# Autodesk Inventor assembly: FEIBOT
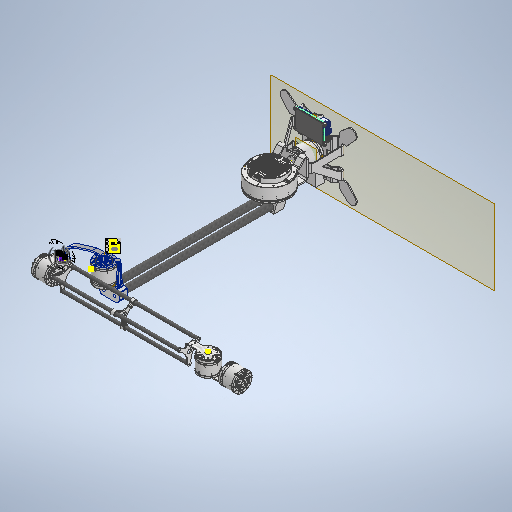
[picture p0: Inventor's stored thumbnail of the model, 512x512]
Saved by Autodesk Inventor 2025.3 (Build 293356000, 356)
## iProperties
Created: 2026-08-06
Part Number: FEIBOT
Document SubType Name: Assembly
Designer: Admin
Author: Admin
## Documents named in this file (21)
- C:\Users\shfzf\Desktop\FEIBOT\ROBOT_CAD\FEIBOT.iam
- C:\Users\shfzf\Desktop\FEIBOT\ROBOT_CAD\BASE\BASE.ipt
- C:\Users\shfzf\Desktop\FEIBOT\ROBOT_CAD\DM-J4340\DM-J4340.iam
- C:\Users\shfzf\Desktop\FEIBOT\ROBOT_CAD\DM-J10010l\DM-J10010l.iam
- C:\Users\shfzf\Desktop\FEIBOT\ROBOT_CAD\J1_J2_FLANGE\J1_J2_FLANGE.ipt
- C:\Users\shfzf\Desktop\FEIBOT\ROBOT_CAD\CARBON_TUBE\CARBON_TUBE_20MM.ipt
- C:\Users\shfzf\Desktop\FEIBOT\ROBOT_CAD\DC_DC_POWER.ipt
- C:\Users\shfzf\Desktop\FEIBOT\ROBOT_CAD\CARBON_TUBE\CARBON_TUBE.ipt
- C:\Users\shfzf\Desktop\FEIBOT\ROBOT_CAD\J4_CAR_CONNECTOR\J4_CAR_CONNECTOR.ipt
- C:\Users\shfzf\Desktop\FEIBOT\ROBOT_CAD\J1_J2_GASKET\J1_J2_GASKET.ipt
- C:\Users\shfzf\Desktop\FEIBOT\ROBOT_CAD\J2_HOLDER\J2_HOLDER.ipt
- C:\Users\shfzf\Desktop\FEIBOT\ROBOT_CAD\J2_CAR_CONNECTOR\J2_CAR_CONNECTOR.ipt
- C:\Users\shfzf\Desktop\FEIBOT\ROBOT_CAD\BOARD.iam
- C:\Users\shfzf\Desktop\FEIBOT\ROBOT_CAD\J3_J4_CONNECTOR.ipt
- C:\Users\shfzf\Desktop\FEIBOT\ROBOT_CAD\J3_J4_CONNECTOR_1.ipt
- C:\Users\shfzf\Desktop\FEIBOT\ROBOT_CAD\J5_J6_CONNECTOR.ipt
- C:\Users\shfzf\Desktop\FEIBOT\ROBOT_CAD\LINK_J3_CONNECTOR.ipt
- C:\Users\shfzf\Desktop\FEIBOT\ROBOT_CAD\DM-J4310\DM-J4310.iam
- C:\Users\shfzf\Desktop\FEIBOT\ROBOT_CAD\CAR_HOLDER.ipt
- C:\Users\shfzf\Desktop\FEIBOT\ROBOT_CAD\CAR_J4_CONNECTOR.ipt
- C:\Users\shfzf\Desktop\FEIBOT\ROBOT_CAD\CAR_TRI_FRAME.ipt
## Components (28 placed, 20 different names)
1. BASE:1 — 配合:1, 配合:2, 配合:3, 配合:4, 配合:5, 配合:6, 配合:22, 配合:23, 配合:24, 配合:36, 配合:37, 角度:1
2. DM-J4340:1 [sub-assembly] — 配合:49, 配合:50, 配合:51, 配合:52, 配合:53, 配合:54
3. DM-J4340:2 [sub-assembly] — 配合:4, 配合:5, 配合:6, 配合:7, 配合:8, 配合:35, 配合:44
4. DM-J10010l:1 [sub-assembly] — 配合:31, 配合:32, 配合:33, 配合:34, 配合:38, 配合:39, 配合:45
5. J1_J2_FLANGE:1 — 配合:7, 配合:8, 配合:25, 配合:26, 配合:30, 配合:44
6. DC_DC_POWER:1 — 配合:22, 配合:23, 配合:24
7. J4_CAR_CONNECTOR:1 — 配合:61, 配合:62, 配合:63, 配合:64, 配合:65, 配合:66, 配合:79, 配合:80, 配合:81, 配合:82, 配合:83
8. J1_J2_GASKET:1 — 配合:25, 配合:26, 配合:27, 配合:28, 配合:29, 配合:35
9. J2_HOLDER:1 — 配合:27, 配合:28, 配合:29, 配合:30, 配合:31, 配合:32, 配合:33, 配合:34
10. J2_CAR_CONNECTOR:1 — 配合:38, 配合:39, 配合:40, 配合:41, 配合:42, 配合:43, 配合:45
11. BOARD:1 [sub-assembly] — 配合:36, 配合:37, 角度:1
12. J3_J4_CONNECTOR:1 — 配合:52, 配合:53, 配合:54, 配合:55, 配合:56, 配合:57
13. J3_J4_CONNECTOR_1:1 — 配合:55, 配合:56, 配合:57, 配合:58, 配合:59, 配合:60
14. J5_J6_CONNECTOR:1 — 配合:67, 配合:68, 配合:69, 配合:70, 配合:71, 配合:72
15. LINK_J3_CONNECTOR:1 — 配合:46, 配合:47, 配合:48, 配合:49, 配合:50, 配合:51
16. DM-J4310:1 [sub-assembly] — 配合:67, 配合:68, 配合:69
17. DM-J4310:2 [sub-assembly] — 配合:70, 配合:71, 配合:72, 配合:73, 配合:74, 配合:75
18. DM-J4310:3 [sub-assembly] — 配合:58, 配合:59, 配合:60, 配合:79, 配合:80, 配合:81, 配合:82, 配合:83
19. CAR_HOLDER:1 — 配合:84, 配合:88, 配合:92
20. CAR_J4_CONNECTOR:1 — 配合:73, 配合:74, 配合:75, 配合:76, 配合:77, 配合:78
21. CAR_TRI_FRAME:1 — 配合:87, 配合:88, 配合:89, 配合:90, 配合:91, 配合:92
22. CAR_HOLDER:2 — 配合:86, 配合:89, 配合:90
23. CAR_HOLDER:3 — 配合:85, 配合:87, 配合:91
24. CARBON_TUBE_20MM:1 — 配合:41, 配合:43, 配合:47
25. CARBON_TUBE_20MM:2 — 配合:40, 配合:42, 配合:46, 配合:48
26. CARBON_TUBE:1 — 配合:61, 配合:65, 配合:76, 配合:78, 配合:86
27. CARBON_TUBE:2 — 配合:62, 配合:66, 配合:84
28. CARBON_TUBE:3 — 配合:63, 配合:64, 配合:77, 配合:85
## Relationships (80: Mate 79, Angle 1)
- 配合:1 [Mate]: BASE:1
- 配合:2 [Mate]: BASE:1
- 配合:3 [Mate]: BASE:1
- 配合:4 [Mate]: BASE:1 ↔ DM-J4340:2
- 配合:5 [Mate]: BASE:1 ↔ DM-J4340:2
- 配合:6 [Mate]: BASE:1 ↔ DM-J4340:2
- 配合:7 [Mate]: DM-J4340:2 ↔ J1_J2_FLANGE:1
- 配合:8 [Mate]: DM-J4340:2 ↔ J1_J2_FLANGE:1
- 配合:22 [Mate]: BASE:1 ↔ DC_DC_POWER:1
- 配合:23 [Mate]: BASE:1 ↔ DC_DC_POWER:1
- 配合:24 [Mate]: BASE:1 ↔ DC_DC_POWER:1
- 配合:25 [Mate]: J1_J2_FLANGE:1 ↔ J1_J2_GASKET:1
- 配合:26 [Mate]: J1_J2_FLANGE:1 ↔ J1_J2_GASKET:1
- 配合:27 [Mate]: J1_J2_GASKET:1 ↔ J2_HOLDER:1
- 配合:28 [Mate]: J1_J2_GASKET:1 ↔ J2_HOLDER:1
- 配合:29 [Mate]: J1_J2_GASKET:1 ↔ J2_HOLDER:1
- 配合:30 [Mate]: J1_J2_FLANGE:1 ↔ J2_HOLDER:1
- 配合:31 [Mate]: DM-J10010l:1 ↔ J2_HOLDER:1
- 配合:32 [Mate]: DM-J10010l:1 ↔ J2_HOLDER:1
- 配合:33 [Mate]: DM-J10010l:1 ↔ J2_HOLDER:1
- 配合:34 [Mate]: DM-J10010l:1 ↔ J2_HOLDER:1
- 配合:35 [Mate]: DM-J4340:2 ↔ J1_J2_GASKET:1
- 配合:36 [Mate]: BASE:1 ↔ BOARD:1
- 配合:37 [Mate]: BASE:1 ↔ BOARD:1
- 角度:1 [Angle] (0 deg): BASE:1 ↔ BOARD:1
- 配合:38 [Mate]: DM-J10010l:1 ↔ J2_CAR_CONNECTOR:1
- 配合:39 [Mate]: DM-J10010l:1 ↔ J2_CAR_CONNECTOR:1
- 配合:40 [Mate]: J2_CAR_CONNECTOR:1 ↔ CARBON_TUBE_20MM:2
- 配合:41 [Mate]: J2_CAR_CONNECTOR:1 ↔ CARBON_TUBE_20MM:1
- 配合:42 [Mate]: J2_CAR_CONNECTOR:1 ↔ CARBON_TUBE_20MM:2
- 配合:43 [Mate]: J2_CAR_CONNECTOR:1 ↔ CARBON_TUBE_20MM:1
- 配合:44 [Mate]: DM-J4340:2 ↔ J1_J2_FLANGE:1
- 配合:45 [Mate]: DM-J10010l:1 ↔ J2_CAR_CONNECTOR:1
- 配合:46 [Mate]: LINK_J3_CONNECTOR:1 ↔ CARBON_TUBE_20MM:2
- 配合:47 [Mate]: LINK_J3_CONNECTOR:1 ↔ CARBON_TUBE_20MM:1
- 配合:48 [Mate]: LINK_J3_CONNECTOR:1 ↔ CARBON_TUBE_20MM:2
- 配合:49 [Mate]: DM-J4340:1 ↔ LINK_J3_CONNECTOR:1
- 配合:50 [Mate]: DM-J4340:1 ↔ LINK_J3_CONNECTOR:1
- 配合:51 [Mate]: DM-J4340:1 ↔ LINK_J3_CONNECTOR:1
- 配合:52 [Mate]: DM-J4340:1 ↔ J3_J4_CONNECTOR:1
- 配合:53 [Mate]: DM-J4340:1 ↔ J3_J4_CONNECTOR:1
- 配合:54 [Mate]: DM-J4340:1 ↔ J3_J4_CONNECTOR:1
- 配合:55 [Mate]: J3_J4_CONNECTOR:1 ↔ J3_J4_CONNECTOR_1:1
- 配合:56 [Mate]: J3_J4_CONNECTOR:1 ↔ J3_J4_CONNECTOR_1:1
- 配合:57 [Mate]: J3_J4_CONNECTOR:1 ↔ J3_J4_CONNECTOR_1:1
- 配合:58 [Mate]: J3_J4_CONNECTOR_1:1 ↔ DM-J4310:3
- 配合:59 [Mate]: J3_J4_CONNECTOR_1:1 ↔ DM-J4310:3
- 配合:60 [Mate]: J3_J4_CONNECTOR_1:1 ↔ DM-J4310:3
- 配合:61 [Mate]: J4_CAR_CONNECTOR:1 ↔ CARBON_TUBE:1
- 配合:62 [Mate]: J4_CAR_CONNECTOR:1 ↔ CARBON_TUBE:2
- 配合:63 [Mate]: J4_CAR_CONNECTOR:1 ↔ CARBON_TUBE:3
- 配合:64 [Mate]: J4_CAR_CONNECTOR:1 ↔ CARBON_TUBE:3
- 配合:65 [Mate]: J4_CAR_CONNECTOR:1 ↔ CARBON_TUBE:1
- 配合:66 [Mate]: J4_CAR_CONNECTOR:1 ↔ CARBON_TUBE:2
- 配合:67 [Mate]: J5_J6_CONNECTOR:1 ↔ DM-J4310:1
- 配合:68 [Mate]: J5_J6_CONNECTOR:1 ↔ DM-J4310:1
- 配合:69 [Mate]: J5_J6_CONNECTOR:1 ↔ DM-J4310:1
- 配合:70 [Mate]: J5_J6_CONNECTOR:1 ↔ DM-J4310:2
- 配合:71 [Mate]: J5_J6_CONNECTOR:1 ↔ DM-J4310:2
- 配合:72 [Mate]: J5_J6_CONNECTOR:1 ↔ DM-J4310:2
- 配合:73 [Mate]: DM-J4310:2 ↔ CAR_J4_CONNECTOR:1
- 配合:74 [Mate]: DM-J4310:2 ↔ CAR_J4_CONNECTOR:1
- 配合:75 [Mate]: DM-J4310:2 ↔ CAR_J4_CONNECTOR:1
- 配合:76 [Mate]: CAR_J4_CONNECTOR:1 ↔ CARBON_TUBE:1
- 配合:77 [Mate]: CAR_J4_CONNECTOR:1 ↔ CARBON_TUBE:3
- 配合:78 [Mate]: CAR_J4_CONNECTOR:1 ↔ CARBON_TUBE:1
- 配合:79 [Mate]: J4_CAR_CONNECTOR:1 ↔ DM-J4310:3
- 配合:80 [Mate]: J4_CAR_CONNECTOR:1 ↔ DM-J4310:3
- 配合:81 [Mate]: J4_CAR_CONNECTOR:1 ↔ DM-J4310:3
- 配合:82 [Mate]: J4_CAR_CONNECTOR:1 ↔ DM-J4310:3
- 配合:83 [Mate]: J4_CAR_CONNECTOR:1 ↔ DM-J4310:3
- 配合:84 [Mate]: CAR_HOLDER:1 ↔ CARBON_TUBE:2
- 配合:85 [Mate]: CAR_HOLDER:3 ↔ CARBON_TUBE:3
- 配合:86 [Mate]: CAR_HOLDER:2 ↔ CARBON_TUBE:1
- 配合:87 [Mate]: CAR_TRI_FRAME:1 ↔ CAR_HOLDER:3
- 配合:88 [Mate]: CAR_HOLDER:1 ↔ CAR_TRI_FRAME:1
- 配合:89 [Mate]: CAR_TRI_FRAME:1 ↔ CAR_HOLDER:2
- 配合:90 [Mate]: CAR_TRI_FRAME:1 ↔ CAR_HOLDER:2
- 配合:91 [Mate]: CAR_TRI_FRAME:1 ↔ CAR_HOLDER:3
- 配合:92 [Mate]: CAR_HOLDER:1 ↔ CAR_TRI_FRAME:1
